# Autodesk Inventor assembly: Huelse_1_komplett
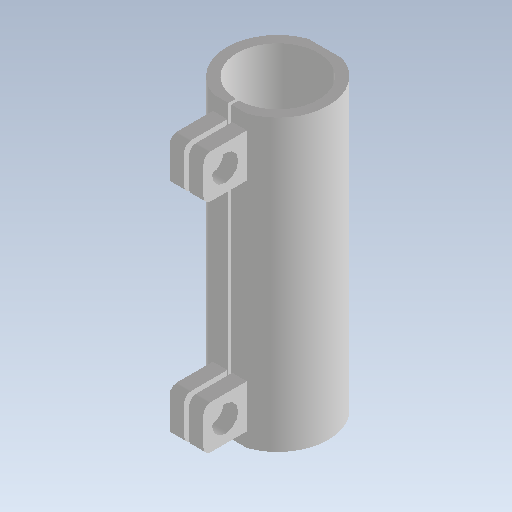
[picture p0: Inventor's stored thumbnail of the model, 512x512]
Saved by Autodesk Inventor 2020.1 (Build 241239000, 239)
## iProperties
Created: 2020-09-10
Part Number: Huelse_1_komplett
Document SubType Name: Assembly
Designer: s5chfeis
Author: s5chfeis
## Documents named in this file (3)
- Z:\Masterarbeit\CAD\CAD\Huelse_1_komplett.iam
- Z:\Masterarbeit\CAD\CAD\Hülse.ipt
- Z:\Masterarbeit\CAD\CAD\Hülse_1.ipt
## Components (5 placed, 2 different names)
1. Hülse:1 — Passend:1, Passend:2, Passend:3, Passend:4, Passend:5, Passend:6, Passend:7, Passend:8, Passend:9, Passend:10, Passend:11
2. Hülse_1:1 — Passend:1, Passend:2, Passend:3
3. Hülse_1:2 — Passend:4, Passend:5
4. Hülse_1:3 — Passend:6, Passend:7, Passend:8
5. Hülse_1:4 — Passend:9, Passend:10, Passend:11
## Relationships (11: Mate 11)
- Passend:1 [Mate]: Hülse:1 ↔ Hülse_1:1
- Passend:2 [Mate] (20 mm): Hülse:1 ↔ Hülse_1:1
- Passend:3 [Mate]: Hülse:1 ↔ Hülse_1:1
- Passend:4 [Mate]: Hülse:1 ↔ Hülse_1:2
- Passend:5 [Mate] (20 mm): Hülse:1 ↔ Hülse_1:2
- Passend:6 [Mate]: Hülse:1 ↔ Hülse_1:3
- Passend:7 [Mate]: Hülse:1 ↔ Hülse_1:3
- Passend:8 [Mate] (5 mm): Hülse:1 ↔ Hülse_1:3
- Passend:9 [Mate]: Hülse:1 ↔ Hülse_1:4
- Passend:10 [Mate]: Hülse:1 ↔ Hülse_1:4
- Passend:11 [Mate] (5 mm): Hülse:1 ↔ Hülse_1:4
